# Autodesk Inventor assembly: Assembly
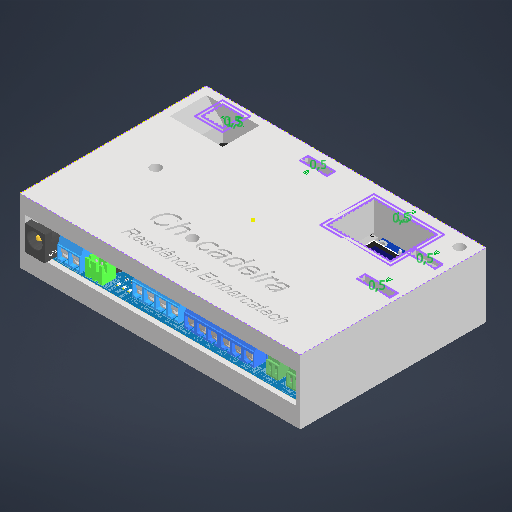
[picture p0: Inventor's stored thumbnail of the model, 512x512]
Saved by Autodesk Inventor 2027 (Build 310192000, 192)
## iProperties
Created: 2026-05-25
Part Number: Assembly
Document SubType Name: Assembly
Designer: Luca Schiavi
Author: Luca Schiavi
## Documents named in this file (4)
- C:\Users\Luca Schiavi\Desktop\Final_Project\Assembly.iam
- C:\Users\Luca Schiavi\Desktop\Final_Project\Inferior_plate.ipt
- C:\Users\Luca Schiavi\Desktop\Final_Project\3D_PCB2_2026-05-22\3D_PCB2_2026-05-22.iam
- C:\Users\Luca Schiavi\Desktop\Final_Project\Superior_plate.ipt
## Components (3 placed, 3 different names)
1. Inferior_plate:1 — Coincidente:1, Alinhado:1, Coincidente:2, Coincidente:4
2. 3D_PCB2_2026-05-22:1 [sub-assembly] — Coincidente:1, Alinhado:1, Coincidente:2, Coincidente:3
3. Superior_plate:1 — Coincidente:3, Coincidente:4
## Relationships (5: Mate 4, Flush 1)
- Coincidente:1 [Mate]: Inferior_plate:1 ↔ 3D_PCB2_2026-05-22:1
- Alinhado:1 [Flush]: Inferior_plate:1 ↔ 3D_PCB2_2026-05-22:1
- Coincidente:2 [Mate]: Inferior_plate:1 ↔ 3D_PCB2_2026-05-22:1
- Coincidente:3 [Mate]: 3D_PCB2_2026-05-22:1 ↔ Superior_plate:1
- Coincidente:4 [Mate]: Inferior_plate:1 ↔ Superior_plate:1
